# Autodesk Inventor assembly: 部件1-2
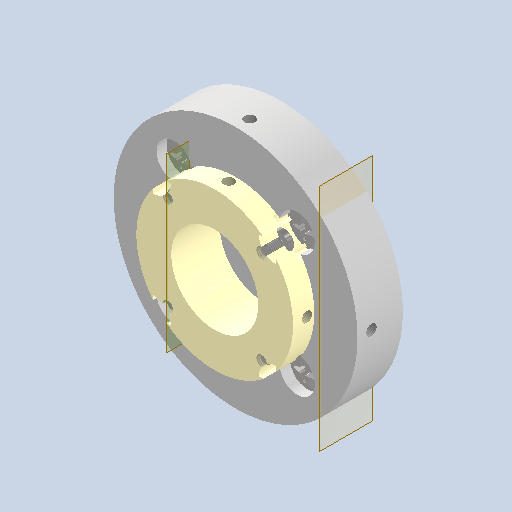
[picture p0: Inventor's stored thumbnail of the model, 512x512]
Saved by Autodesk Inventor 2025 (Build 290162000, 162)
## iProperties
Created: 2026-11-10
Part Number: 部件1-2
Document SubType Name: Assembly
Designer: test
Author: test
## Documents named in this file (5)
- D:\Desktop\CR5A连接件\部件1-2.iam
- D:\Desktop\CR5A连接件\零件1 - 副本.ipt
- D:\Desktop\CR5A连接件\零件2 - 副本.ipt
- D:\Documents\Inventor\Content Center Files\R2025\zh-CN\GB_T 818-2000 H\螺钉 GB_T 818 M3 x 4.ipt
- D:\Documents\Inventor\Content Center Files\R2025\zh-CN\GB_T 818-2000 H\螺钉 GB_T 818 M6 x 12.ipt
## Components (10 placed, 4 different names)
1. 零件1 - 副本:1 — 插入:1, 配合:4, 配合:5
2. 零件2 - 副本:1 — 配合:1, 配合:2, 配合:4, 配合:5
3. 螺钉 GB/T 818-2000 H 型 M6 x 12:1 — 配合:1, 配合:2
4. 螺钉 GB/T 818-2000 H 型 M6 x 12:2
5. 螺钉 GB/T 818-2000 H 型 M6 x 12:3
6. 螺钉 GB/T 818-2000 H 型 M6 x 12:4
7. 螺钉 GB/T 818-2000 H 型 M3 x 4:1 — 插入:1
8. 螺钉 GB/T 818-2000 H 型 M3 x 4:2
9. 螺钉 GB/T 818-2000 H 型 M3 x 4:3
10. 螺钉 GB/T 818-2000 H 型 M3 x 4:4
## Component patterns: (4 elements, first: 螺钉 GB/T 818-2000 H 型 M6 x 12:1), (4 elements, first: 螺钉 GB/T 818-2000 H 型 M3 x 4:1)
## Relationships (5: Mate 4, Insert 1)
- 插入:1 [Insert]: 零件1 - 副本:1 ↔ 螺钉 GB/T 818-2000 H 型 M3 x 4:1
- 配合:1 [Mate]: 零件2 - 副本:1 ↔ 螺钉 GB/T 818-2000 H 型 M6 x 12:1
- 配合:2 [Mate]: 零件2 - 副本:1 ↔ 螺钉 GB/T 818-2000 H 型 M6 x 12:1
- 配合:4 [Mate]: 零件1 - 副本:1 ↔ 零件2 - 副本:1
- 配合:5 [Mate]: 零件1 - 副本:1 ↔ 零件2 - 副本:1
